# Autodesk Inventor assembly: MM0948AN170_G00_816
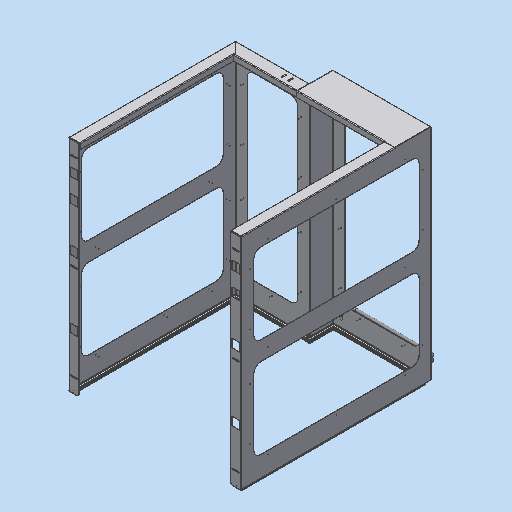
[picture p0: Inventor's stored thumbnail of the model, 512x512]
Saved by Autodesk Inventor 2023.3 (Build 273359000, 359)
## iProperties
Part Number: MM0948AN170_G00_816
Material: Generisch
Description: =<RBPARTNOTITLE2>
Document SubType Name: Assembly
Designer: FH/Wi
Mass: 15312.9 g
Surface Area: 26051.4 cm^2
Volume: 2071.78 cm^3
Density: 7.39116 g/cm^3
Created: 2023-03-23
RBCHANGEDESCRIPTION1: Erstfreigabe
RBCHANGENO1: 00
RBDOCUMENTTYPE: DRF
RBDOCUMENTVERSION: 00
RBDRAWINGMAINSCALE: 1:1
RBDRAWINGMISSINGSPEC: --
RBDRAWINGVOLUME: --
RBDSV1: 0850
RBGBDETAILS: 43274
RBGBEDGESIN1: +0,5
RBGBEDGESIN2: +0,2
RBGBEDGESOUT1: -0,3
RBGBEDGESOUT2: -0,1
RBMATERIAL: =<Material>
RBMATMEETS: --
RBMATNO: =<Part Number>
RBORGUNITRESPONSIBLE1: AnP/TEF1
RBPARTMADEOF: --
RBPARTNO: SIEHE MNR
RBPARTNOTITLE1: enter description here
RBPARTNOTITLE2: hier Bezeichnung eintragen
RBPARTSAFETYINDICATOR: --
RBSURFACE: painted black
RBSURFACE2: matt schwarz lackiert
RBZEDGESNORM: ISO13715:2002-06
RBZGENDIMCLASS: m
RBZGENDIMNORM: ISO 2768-1:1989-11
RBZGENGEOCLASS: H
RBZGENGEONORM: ISO 2768-2:1989-11
RBZSURFACENORM: ISO13D2:2002-02
RBZTOLERANCENORM: ISO 14405-1:2010-12
AnP_Kommentar: --
MaxAbmaße: --
AnP_TemplVers: 20190222
AnP_Kategorie: 98
AnP_Material: =<Material>
Author: FH/Wi
Keywords: =<RBPARTMADEOF>
Comments: =<RBSURFACE2>
Revision Number: 01
## Documents named in this file (6)
- C:\Users\rea9an\Documents\Inventor\TCAI2412_te1910_EM\AS00000967.iam
- C:\Users\rea9an\Documents\Inventor\TCAI2412_te1910_EM\PT00004485.ipt
- C:\Users\rea9an\Documents\Inventor\TCAI2412_te1910_EM\PT00004539.ipt
- C:\Users\rea9an\Documents\Inventor\TCAI2412_te1910_EM\PT00004707.ipt
- C:\Users\rea9an\Documents\Inventor\TCAI2412_te1910_EM\PT00004709.ipt
- C:\Users\rea9an\Documents\Inventor\TCAI2412_te1910_EM\PT00004710.ipt
## Components (5 placed, 5 different names)
1. PT00004710:1
2. PT00004709:1
3. PT00004707:1 — Fluchtend:1, Fluchtend:4, Fluchtend:5, Fluchtend:6, Fluchtend:9, Einfügen:1, Einfügen:2
4. PT00004485:1 — Fluchtend:1, Fluchtend:9
5. PT00004539:1 — Einfügen:1, Einfügen:2
## Relationships (10: Flush 6, Mate 2, Insert 2)
- Fluchtend:1 [Flush]: PT00004707:1 ↔ PT00004485:1
- Fluchtend:4 [Flush]: PT00004707:1
- Fluchtend:5 [Flush]: PT00004707:1
- Fluchtend:6 [Flush]: PT00004707:1
- Fluchtend:9 [Flush]: PT00004707:1 ↔ PT00004485:1
- [Mate]: PT00004709:1 ↔ PT00004707:1
- [Mate]: PT00004709:1 ↔ PT00004485:1
- [Flush]: PT00004710:1 ↔ PT00004709:1
- Einfügen:1 [Insert]: PT00004707:1 ↔ PT00004539:1
- Einfügen:2 [Insert]: PT00004707:1 ↔ PT00004539:1
